# Autodesk Inventor assembly: circuit-mount
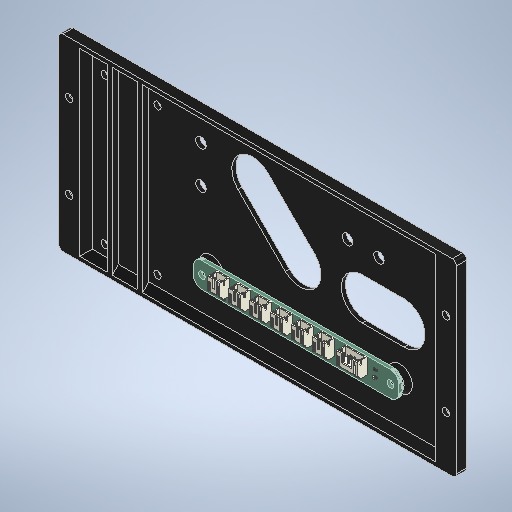
[picture p0: Inventor's stored thumbnail of the model, 512x512]
Saved by Autodesk Inventor 2025.3 (Build 293356030, 356C)
## iProperties
Created: 2025-09-04
Part Number: circuit-mount
Document SubType Name: Assembly
Designer: ibuki_ono
Author: ibuki_ono
## Documents named in this file (3)
- C:\Users\ibuki_ono\Documents\hobby\rogiken\catchrobo\CAD\Hardware_CAD\Inventor\circuit\circuit-mount.iam
- C:\Users\ibuki_ono\Documents\hobby\rogiken\catchrobo\CAD\Hardware_CAD\Inventor\circuit\3D_plate-fix.ipt
- C:\Users\ibuki_ono\Documents\hobby\rogiken\catchrobo\CAD\Hardware_CAD\Inventor\circuit\CAN-hub\CAN-hub\CAN-hub.iam
## Components (2 placed, 2 different names)
1. 3D_plate-fix:1 — 挿入:1, 挿入:2
2. CAN-hub:1 [sub-assembly] — 挿入:1, 挿入:2
## Relationships (2: Insert 2)
- 挿入:1 [Insert]: 3D_plate-fix:1 ↔ CAN-hub:1
- 挿入:2 [Insert]: 3D_plate-fix:1 ↔ CAN-hub:1
